# Autodesk Inventor assembly: MM0948AN002_G10_801
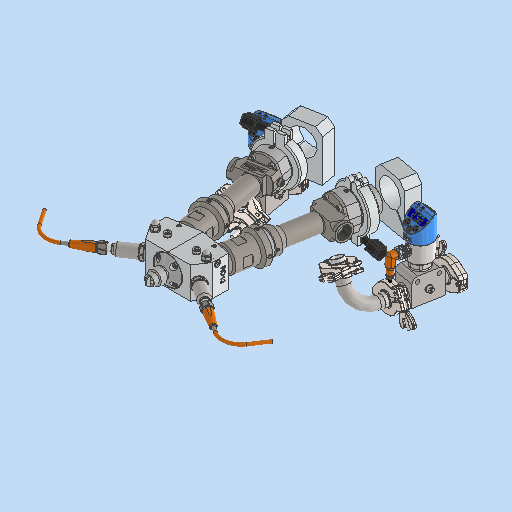
[picture p0: Inventor's stored thumbnail of the model, 512x512]
Saved by Autodesk Inventor 2023.3 (Build 273359000, 359)
## iProperties
RuleStatus: InUse
Created: 2022-12-20
Part Number: MM0948AN002_G10_801
Description: =<RBPARTNOTITLE2>
Document SubType Name: Assembly
Designer: ric7an
Mass: 7285.92 g
Surface Area: 4622.86 cm^2
Volume: 1211.36 cm^3
Density: 6.01467 g/cm^3
Vendor: Viscotec
RBDRAWINGMISSINGSPEC: --
RBGBREMARKSINDEX: E
RBSURFACE: --
RBPARTNOTITLE1: Viscotec ViscoDuo-VM 12/12
AnP_Kategorie: 98
AnP_Material: =<Material>
RBPARTNOTITLE2: Viscotec ViscoDuo-VM 12/12
RBMATERIAL: =<Material>
MaxAbmaße: 197,038 x 590,446 x 367,637 (FM)
RBPARTMADEOF: nach Angebot
Author: ric7an
Keywords: =<RBPARTMADEOF>
Comments: =<RBSURFACE2>
Revision Number: 01
## Documents named in this file (6)
- C:\Users\rea9an\Documents\Inventor\TCAI2412_te1910_EM\AS00000927.iam
- C:\Users\rea9an\Documents\Inventor\TCAI2412_te1910_EM\PT00004586.ipt
- C:\Users\rea9an\Documents\Inventor\TCAI2412_te1910_EM\PT00004531.ipt
- C:\Users\rea9an\Documents\Inventor\TCAI2412_te1910_EM\PT00004587.ipt
- C:\Users\rea9an\Documents\Inventor\TCAI2412_te1910_EM\PT00004588.ipt
- C:\Users\rea9an\Documents\Inventor\TCAI2412_te1910_EM\PT00004589.ipt
## Components (9 placed, 5 different names)
1. PT00004586:1 — Passend:9, Passend:10
2. PT00004531:1 — Winkel:4, Passend:9
3. PT00004531:2 — Winkel:5, Passend:10
4. PT00004587:1 — Einfügen:1
5. PT00004589:1 — Einfügen:1, Winkel:4, Einfügen:4, Winkel:6
6. PT00004587:2 — Einfügen:3
7. PT00004588:1 — Einfügen:2, Winkel:2
8. PT00004589:2 — Einfügen:2, Einfügen:3, Winkel:2, Winkel:5
9. PT00004588:2 — Einfügen:4, Winkel:6
## Relationships (21: Mate 10, Angle 6, Insert 4, Flush 1)
- [Mate] (113.5 mm): PT00004586:1 ↔ PT00004587:1
- [Mate]: PT00004586:1 ↔ PT00004587:1
- [Mate]: PT00004586:1 ↔ PT00004587:1
- [Angle] (30 deg): PT00004586:1 ↔ PT00004587:1
- Einfügen:1 [Insert]: PT00004587:1 ↔ PT00004589:1
- Einfügen:2 [Insert]: PT00004588:1 ↔ PT00004589:2
- Einfügen:3 [Insert]: PT00004587:2 ↔ PT00004589:2
- Winkel:2 [Angle] (270 deg): PT00004588:1 ↔ PT00004589:2
- [Mate]: PT00004586:1 ↔ PT00004587:2
- [Mate] (113.5 mm): PT00004586:1 ↔ PT00004587:2
- [Mate] (46.5 mm): PT00004586:1 ↔ PT00004587:2
- [Angle] (155 deg): PT00004586:1 ↔ PT00004587:2
- Winkel:4 [Angle] (180 deg): PT00004531:1 ↔ PT00004589:1
- Winkel:5 [Angle] (180 deg): PT00004531:2 ↔ PT00004589:2
- [Flush]: PT00004531:1 ↔ PT00004531:2
- [Mate] (37.195 mm): PT00004586:1 ↔ PT00004531:2
- [Mate] (37.195 mm): PT00004586:1 ↔ PT00004531:1
- Einfügen:4 [Insert]: PT00004589:1 ↔ PT00004588:2
- Winkel:6 [Angle] (90 deg): PT00004589:1 ↔ PT00004588:2
- Passend:9 [Mate]: PT00004586:1 ↔ PT00004531:1
- Passend:10 [Mate]: PT00004586:1 ↔ PT00004531:2
## Named parameters: d30_d29 = 270 deg, d31_d27 = 0 mm, d32_d28 = 0 mm
